# Autodesk Inventor assembly: RDS-1000 Tank with Mixer
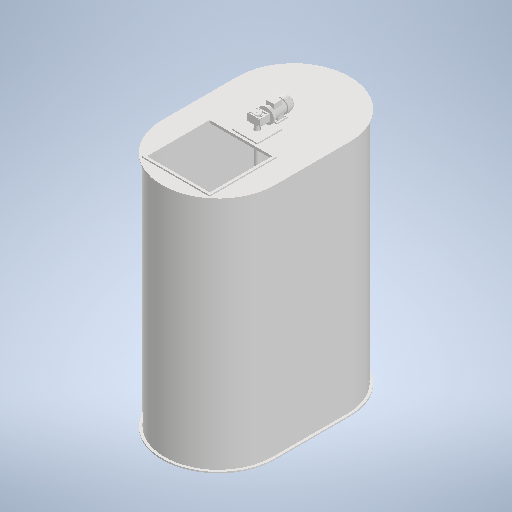
[picture p0: Inventor's stored thumbnail of the model, 512x512]
Saved by Autodesk Inventor 2026 (Build 300175000, 175)
## iProperties
Created: 2026-10-12
Part Number: RDS-1000 Tank with Mixer
Description: Tank 2 m3 with mixer
Document SubType Name: Assembly
Designer: admin
Stock Number: Емкость 2 м3 Парфино с мешалкой
Author: admin
## Documents named in this file (7)
- C:\Users\user\Documents\Inventor\RDS-Reagent-Dosing-Station\Tank\RDS-1000 Tank with Mixer.iam
- C:\Users\user\Documents\Inventor\RDS-Reagent-Dosing-Station\Tank\RDS-1001 Tank 2m3 Parfino.ipt
- C:\Users\user\Documents\Inventor\RDS-Reagent-Dosing-Station\Purchased\RDS-5005 Gear Motor.ipt
- C:\Users\user\Documents\Inventor\RDS-Reagent-Dosing-Station\Purchased\Mixer\RDS-5101 Shaft 3.ipt
- C:\Users\user\Documents\Inventor\RDS-Reagent-Dosing-Station\Purchased\Mixer\RDS-5102 Vane.ipt
- C:\Users\user\Documents\Inventor\RDS-Reagent-Dosing-Station\Purchased\Mixer\RDS-5103 Shaft 2.ipt
- C:\Users\user\Documents\Inventor\RDS-Reagent-Dosing-Station\Purchased\Mixer\RDS-5104 Bushing.ipt
## Components (7 placed, 6 different names)
1. RDS-1001 Tank 2m3 Parfino:1 — Цилиндрический:1
2. RDS-5005 Gear Motor:1 — Цилиндрический:2
3. RDS-5101 Shaft 3:1 — Жесткий:2, Жесткий:3, С поворотом:1
4. RDS-5102 Vane:1 — С поворотом:1
5. RDS-5102 Vane:2 — Жесткий:3
6. RDS-5103 Shaft 2:1 — Жесткий:1, Жесткий:2, Цилиндрический:2
7. RDS-5104 Bushing:1 — Цилиндрический:1, Жесткий:1
## Relationships (6: WeldJoint 3, CylindricalJoint 2, RevoluteJoint 1)
- Цилиндрический:1 [CylindricalJoint]: RDS-1001 Tank 2m3 Parfino:1 ↔ RDS-5104 Bushing:1
- Жесткий:1 [WeldJoint]: RDS-5103 Shaft 2:1 ↔ RDS-5104 Bushing:1
- Жесткий:2 [WeldJoint]: RDS-5101 Shaft 3:1 ↔ RDS-5103 Shaft 2:1
- Цилиндрический:2 [CylindricalJoint]: RDS-5005 Gear Motor:1 ↔ RDS-5103 Shaft 2:1
- Жесткий:3 [WeldJoint]: RDS-5101 Shaft 3:1 ↔ RDS-5102 Vane:2
- С поворотом:1 [RevoluteJoint]: RDS-5101 Shaft 3:1 ↔ RDS-5102 Vane:1
